# Autodesk Inventor assembly: SPE7V1 Base Paciente (Soldadura)
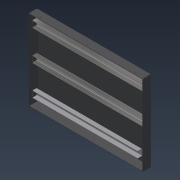
[picture p0: Inventor's stored thumbnail of the model, 180x180]
Saved by Autodesk Inventor 2021.2 (Build 252289000, 289)
## iProperties
Created: 2026-10-27
Part Number: SPE7V1 Base Paciente (Soldadura)
Document SubType Name: Assembly
Designer: Tecnica
Author: Tecnica
## Documents named in this file (4)
- C:\Users\Tecnica\OneDrive\Documentos\Mecanica\Soporte-Paciente-Espinografia\Workspace\SPE7V1 Base Paciente (Soldadura).iam
- C:\Users\Tecnica\OneDrive\Documentos\Mecanica\Soporte-Paciente-Espinografia\Workspace\SP42V1 Base Chapa.ipt
- C:\Users\Tecnica\OneDrive\Documentos\Mecanica\Soporte-Paciente-Espinografia\Workspace\SP41V1 Refuerzo.ipt
- C:\Users\Tecnica\OneDrive\Documentos\Mecanica\Soporte-Paciente-Espinografia\Workspace\SP40V1 Refuerzo pasador.ipt
## Components (4 placed, 3 different names)
1. SP40V1 Refuerzo pasador:1
2. SP41V1 Refuerzo:1
3. SP41V1 Refuerzo:2
4. SP42V1 Base Chapa:1
## Relationships (9: Mate 6, Flush 3)
- [Mate]: SP40V1 Refuerzo pasador:1 ↔ SP42V1 Base Chapa:1
- [Mate]: SP41V1 Refuerzo:2 ↔ SP42V1 Base Chapa:1
- [Mate]: SP41V1 Refuerzo:1 ↔ SP42V1 Base Chapa:1
- [Mate]: SP41V1 Refuerzo:2 ↔ SP42V1 Base Chapa:1
- [Mate]: SP40V1 Refuerzo pasador:1 ↔ SP42V1 Base Chapa:1
- [Mate]: SP41V1 Refuerzo:1 ↔ SP42V1 Base Chapa:1
- [Flush]: SP40V1 Refuerzo pasador:1 ↔ SP42V1 Base Chapa:1
- [Flush]: SP41V1 Refuerzo:1 ↔ SP42V1 Base Chapa:1
- [Flush]: SP41V1 Refuerzo:2 ↔ SP42V1 Base Chapa:1
